# Autodesk Inventor assembly: Ir
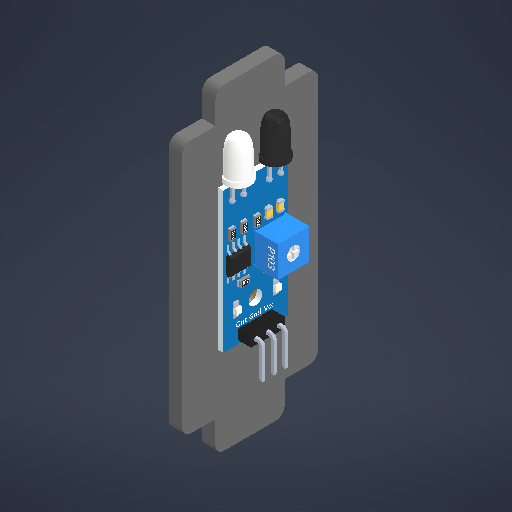
[picture p0: Inventor's stored thumbnail of the model, 512x512]
Saved by Autodesk Inventor 2027.1 (Build 311270010, 270A)
## iProperties
Created: 2026-11-04
Part Number: Ir
Document SubType Name: Assembly
Designer: SDS Scholar
Author: SDS Scholar
## Documents named in this file (6)
- C:\Users\Ahmed\Desktop\Fall 26\Design 1 Repo\MCT333_Design_of_Mechatronics_Systems_1\CAD\cartesian_robot_workspace\Ir.iam
- C:\Users\Ahmed\Desktop\Fall 26\Design 1 Repo\MCT333_Design_of_Mechatronics_Systems_1\CAD\cartesian_robot_workspace\Ir_mount.ipt
- C:\Users\Ahmed\Desktop\Fall 26\Design 1 Repo\MCT333_Design_of_Mechatronics_Systems_1\CAD\electronic_components\ir-sensor\IRsensors\IRsensors.iam
- C:\Users\SDS Scholar\Documents\Inventor\Content Center Files\R2027\en-US\BS EN ISO 7045 H\EN ISO 7045 - M3 x 10 - 4.8 - H(1).ipt
- C:\Users\Ahmed\Documents\Inventor\Content Center Files\R2027\en-US\ANSI B18.22 M\ANSI B18.22M - 3 N.ipt
- C:\Users\SDS Scholar\Documents\Inventor\Content Center Files\R2027\en-US\ANSI B 18.2.4.1 M(1)\ANSI B 18.2.4.1 M - M3 x 0.5Style 1.ipt
## Components (5 placed, 5 different names)
1. Ir_mount:1 — Flush:1, Flush:2, Flush:3, Mate:1, Mate:2, Angle:1, Mate:5
2. IRsensors:1 [sub-assembly] — Mate:1, Mate:2, Angle:1, Mate:3, Mate:4
3. BS EN ISO 7045 H - Metric M3 x 10 - 4.8 - H:1 — Mate:3, Mate:4, Mate:6, Mate:7
4. Plain Washer (Metric) 3 N:1 — Mate:5, Mate:6, Mate:8
5. Hex Nut Metric M3 x 0.5:1 — Mate:7, Mate:8
## Relationships (12: Mate 8, Flush 3, Angle 1)
- Flush:1: Ir_mount:1
- Flush:2: Ir_mount:1
- Flush:3: Ir_mount:1
- Mate:1: Ir_mount:1 ↔ IRsensors:1
- Mate:2: Ir_mount:1 ↔ IRsensors:1
- Angle:1 (0 deg): Ir_mount:1 ↔ IRsensors:1
- Mate:3: IRsensors:1 ↔ BS EN ISO 7045 H - Metric M3 x 10 - 4.8 - H:1
- Mate:4: IRsensors:1 ↔ BS EN ISO 7045 H - Metric M3 x 10 - 4.8 - H:1
- Mate:5: Ir_mount:1 ↔ Plain Washer (Metric) 3 N:1
- Mate:6: BS EN ISO 7045 H - Metric M3 x 10 - 4.8 - H:1 ↔ Plain Washer (Metric) 3 N:1
- Mate:7: BS EN ISO 7045 H - Metric M3 x 10 - 4.8 - H:1 ↔ Hex Nut Metric M3 x 0.5:1
- Mate:8: Plain Washer (Metric) 3 N:1 ↔ Hex Nut Metric M3 x 0.5:1
